# Autodesk Inventor assembly: MM0885AN110_G02_802
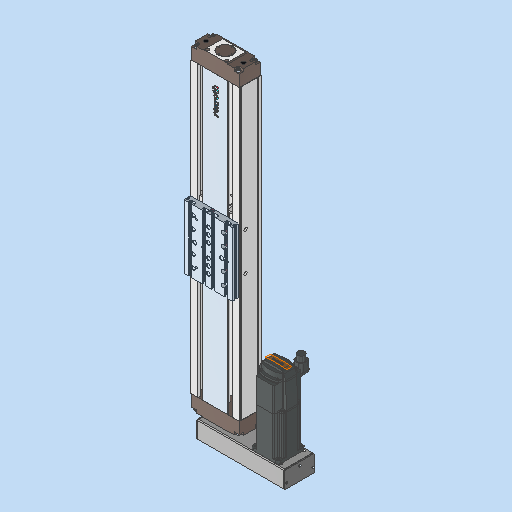
[picture p0: Inventor's stored thumbnail of the model, 512x512]
Saved by Autodesk Inventor 2023.3 (Build 273359000, 359)
## iProperties
RuleStatus: InUse
Created: 2021-01-18
Part Number: MM0885AN110_G02_802
Description: =<RBPARTNOTITLE2>
Document SubType Name: Assembly
Designer: ric7an
Mass: 62765.9 g
Surface Area: 12291 cm^2
Volume: 7501.65 cm^3
Density: 8.36695 g/cm^3
Vendor: Bosch Rexroth
AnP_Kategorie: 11
AnP_Material: =<Material>
AnP_TemplVers: 20200821
RBDOCUMENTTYPE: DRF
RBDOCUMENTVERSION: 00
RBDRAWINGMAINSCALE: 1:1
RBDRAWINGMISSINGSPEC: --
RBDRAWINGVOLUME: --
RBDSV1: 0850
RBGBEDGESIN1: +0,5
RBGBEDGESIN2: +0,2
RBGBEDGESOUT1: -0,3
RBGBEDGESOUT2: -0,1
RBGBREMARKSINDEX: E
RBMATERIAL: =<Material>
RBMATMEETS: --
RBMATNO: =<Part Number>
RBPARTMADEOF: CKK145 - nach Datenblatt
RBPARTNO: SIEHE MNR
RBPARTNOTITLE1: CKK-145 linear axis
RBPARTNOTITLE2: CKK-145 Linearachse
RBPARTSAFETYINDICATOR: --
RBSURFACE: --
RBSURFACE2: --
RBZEDGESNORM: ISO13715:2002-06
RBZGENDIMCLASS: m
RBZGENDIMNORM: ISO 2768-1:1989-11
RBZGENGEOCLASS: H
RBZGENGEONORM: ISO 2768-2:1989-11
RBZSURFACENORM: ISO13D2:2002-02
RBZTOLERANCENORM: ISO 14405-1:2010-12
Author: ric7an
Keywords: =<RBPARTMADEOF>
Comments: =<RBSURFACE2>
Revision Number: 01
## Documents named in this file (3)
- C:\Users\rea9an\Documents\Inventor\TCAI2412_te1910_EM\AS00000904.iam
- C:\Users\rea9an\Documents\Inventor\TCAI2412_te1910_EM\PT00004524.ipt
- C:\Users\rea9an\Documents\Inventor\TCAI2412_te1910_EM\PT00004527.ipt
## Components (2 placed, 2 different names)
1. PT00004527:1 — Fluchtend:2, Fluchtend:3, Passend:1
2. PT00004524:1 — Fluchtend:2, Fluchtend:3, Passend:1
## Relationships (3: Flush 2, Mate 1)
- Fluchtend:2 [Flush]: PT00004527:1 ↔ PT00004524:1
- Fluchtend:3 [Flush] (-21 mm): PT00004527:1 ↔ PT00004524:1
- Passend:1 [Mate] (10 mm): PT00004527:1 ↔ PT00004524:1
